# Autodesk Inventor assembly: Mecanismo_MG90S
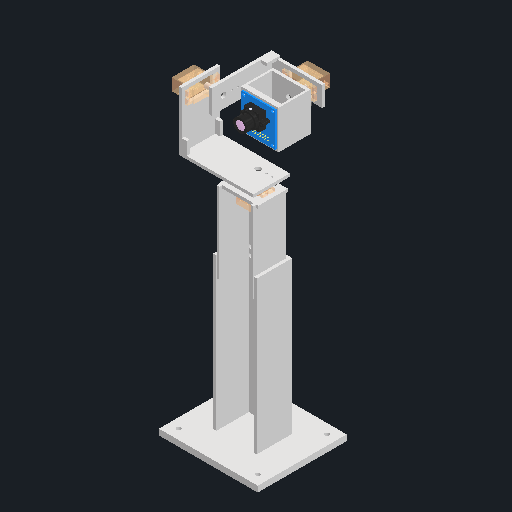
[picture p0: Inventor's stored thumbnail of the model, 512x512]
Saved by Autodesk Inventor 2027.2 (Build 312334000, 334)
## iProperties
Created: 2026-11-14
Part Number: Mecanismo_MG90S
Document SubType Name: Assembly
Designer: alexa
Author: alexa
Comments: Centro mecanico nominal a 286 mm del apoyo. Ejes concurrentes y centro fijo verificados en 27 posiciones {-30,0,30} grados. Calculo estatico: PETG macizo 1.27 g/cm3, camara 20 g, servos segun TowerPro; cableado/hardware como margen. No es ensayo fisico ni par continuo. Angulos de pantalla: aproximacion plana nominal 596.736 x 335.664 mm a 250 mm, FOV horizontal supuesto 25 grados. MG996R conserva acoples originales; MG90S usa brazos comerciales suministrados. https://towerpro.com.tw/product/mg90s-3/ https://towerpro.com.tw/product/mg996r/
## Documents named in this file (9)
- C:\Users\alexa\tesis-star-tracker\Inventor\Mecanismo_3GDL\Mecanismo_MG90S\Mecanismo_MG90S.iam
- C:\Users\alexa\tesis-star-tracker\Inventor\Mecanismo_3GDL\Mecanismo_MG90S\01_Base.ipt
- C:\Users\alexa\tesis-star-tracker\Inventor\Mecanismo_3GDL\Mecanismo_MG90S\02_Columna.ipt
- C:\Users\alexa\tesis-star-tracker\Inventor\Mecanismo_3GDL\Mecanismo_MG90S\03_Brazo_yaw.ipt
- C:\Users\alexa\tesis-star-tracker\Inventor\Mecanismo_3GDL\Mecanismo_MG90S\04_Brazo_pitch.ipt
- C:\Users\alexa\tesis-star-tracker\Inventor\Mecanismo_3GDL\Mecanismo_MG90S\05_Portacam.ipt
- C:\Users\alexa\tesis-star-tracker\Inventor\Mecanismo_3GDL\Mecanismo_MG90S\MG90S_referencia.ipt
- C:\Users\alexa\tesis-star-tracker\Inventor\Mecanismo_3GDL\Mecanismo_MG90S\Horn_MG90S_referencia.ipt
- C:\Users\alexa\tesis-star-tracker\Inventor\Mecanismo_3GDL\Mecanismo_MG90S\OV7670_referencia.ipt
## Components (12 placed, 12 different names)
1. 01_Base
2. 02_Columna — Yaw_coaxial, Yaw_axial, Giro_Yaw, Nivelación:4, Nivelación:5, Nivelación:6
3. 03_Yaw — Yaw_coaxial, Yaw_axial, Giro_Yaw, Pitch_coaxial, Pitch_axial, Giro_Pitch, Nivelación:7, Nivelación:8, Nivelación:9, Nivelación:13, Nivelación:14, Nivelación:15
4. 04_Pitch — Pitch_coaxial, Pitch_axial, Giro_Pitch, Roll_coaxial, Roll_axial, Giro_Roll, Nivelación:10, Nivelación:11, Nivelación:12, Nivelación:16, Nivelación:17, Nivelación:18
5. 05_Camara — Roll_coaxial, Roll_axial, Giro_Roll, Nivelación:19, Nivelación:20, Nivelación:21, Nivelación:22, Nivelación:23, Nivelación:24
6. Servo_yaw — Nivelación:4, Nivelación:5, Nivelación:6
7. Servo_pitch — Nivelación:7, Nivelación:8, Nivelación:9
8. Servo_roll — Nivelación:10, Nivelación:11, Nivelación:12
9. Horn_yaw — Nivelación:13, Nivelación:14, Nivelación:15
10. Horn_pitch — Nivelación:16, Nivelación:17, Nivelación:18
11. Horn_roll — Nivelación:19, Nivelación:20, Nivelación:21
12. OV7670 — Nivelación:22, Nivelación:23, Nivelación:24
## Relationships (30: Flush 24, Mate 3, Angle 3)
- Yaw_coaxial [Mate]: 02_Columna ↔ 03_Yaw
- Yaw_axial [Flush]: 02_Columna ↔ 03_Yaw
- Giro_Yaw [Angle] (0 deg): 02_Columna ↔ 03_Yaw
- Pitch_coaxial [Mate]: 03_Yaw ↔ 04_Pitch
- Pitch_axial [Flush]: 03_Yaw ↔ 04_Pitch
- Giro_Pitch [Angle] (0 deg): 03_Yaw ↔ 04_Pitch
- Roll_coaxial [Mate]: 04_Pitch ↔ 05_Camara
- Roll_axial [Flush]: 04_Pitch ↔ 05_Camara
- Giro_Roll [Angle] (0 deg): 04_Pitch ↔ 05_Camara
- Nivelación:4 [Flush]: 02_Columna ↔ Servo_yaw
- Nivelación:5 [Flush]: 02_Columna ↔ Servo_yaw
- Nivelación:6 [Flush]: 02_Columna ↔ Servo_yaw
- Nivelación:7 [Flush]: 03_Yaw ↔ Servo_pitch
- Nivelación:8 [Flush]: 03_Yaw ↔ Servo_pitch
- Nivelación:9 [Flush]: 03_Yaw ↔ Servo_pitch
- Nivelación:10 [Flush]: 04_Pitch ↔ Servo_roll
- Nivelación:11 [Flush]: 04_Pitch ↔ Servo_roll
- Nivelación:12 [Flush]: 04_Pitch ↔ Servo_roll
- Nivelación:13 [Flush]: 03_Yaw ↔ Horn_yaw
- Nivelación:14 [Flush]: 03_Yaw ↔ Horn_yaw
- Nivelación:15 [Flush]: 03_Yaw ↔ Horn_yaw
- Nivelación:16 [Flush]: 04_Pitch ↔ Horn_pitch
- Nivelación:17 [Flush]: 04_Pitch ↔ Horn_pitch
- Nivelación:18 [Flush]: 04_Pitch ↔ Horn_pitch
- Nivelación:19 [Flush]: 05_Camara ↔ Horn_roll
- Nivelación:20 [Flush]: 05_Camara ↔ Horn_roll
- Nivelación:21 [Flush]: 05_Camara ↔ Horn_roll
- Nivelación:22 [Flush]: 05_Camara ↔ OV7670
- Nivelación:23 [Flush]: 05_Camara ↔ OV7670
- Nivelación:24 [Flush]: 05_Camara ↔ OV7670
## Named parameters: Altura_centro = 286 mm, Distancia_monitor = 250 mm, Yaw_cuadro_completo_nominal = 37.540646 deg, Pitch_cuadro_completo_nominal = 24.434305 deg, Par_pitch_estimado_kgfcm = 0.156735, Par_roll_estimado_kgfcm = 0.0475979, Centro_X = 0 mm, Centro_Y = 286 mm, Centro_Z = 0 mm, Masa_camara_supuesta = 0.02, Masa_cables_supuesta = 0.01, Monitor_ancho_nominal = 596.736 mm, Monitor_alto_nominal = 335.664 mm, FOV_H_nominal = 25 deg, FOV_V_nominal = 18.880527 deg, Pitch_con_yaw30_roll30 = 17.63023 deg
note: some values were not read from the file. Shown as the stored number, unit unknown: "Masa_camara_supuesta", "Masa_cables_supuesta".
